# Autodesk Inventor assembly: Assembly1
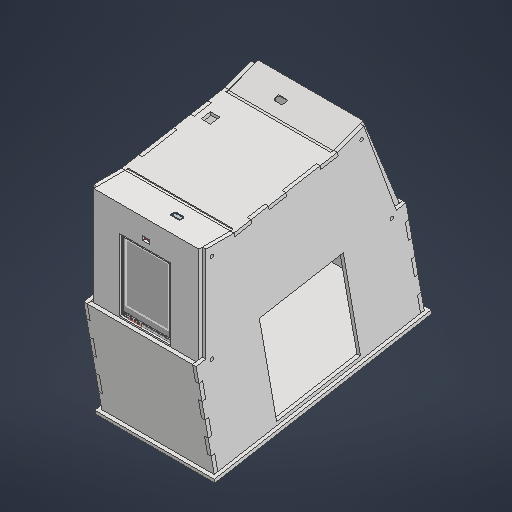
[picture p0: Inventor's stored thumbnail of the model, 512x512]
Saved by Autodesk Inventor 2027.1 (Build 311270010, 270A)
## iProperties
Created: 2026-10-11
Part Number: Assembly1
Document SubType Name: Assembly
Designer: MineS
Author: MineS
## Documents named in this file (10)
- C:\Users\MineS\Desktop\Carcasa videojuego\Assembly1.iam
- C:\Users\MineS\Desktop\Carcasa videojuego\NUCLEO-60-F401\NUCLEO-60-F401.ipt
- C:\Users\MineS\Desktop\Carcasa videojuego\2.4TFT_Module\2.4TFT_Module.ipt
- C:\Users\MineS\Desktop\Carcasa videojuego\base_stm.ipt
- C:\Users\MineS\Desktop\Carcasa videojuego\tapadera_pantalla.ipt
- C:\Users\MineS\Desktop\Carcasa videojuego\tapaderalateral.ipt
- C:\Users\MineS\Desktop\Carcasa videojuego\tapafrontalmdf.ipt
- C:\Users\MineS\Desktop\Carcasa videojuego\tapaderalateralbocina.ipt
- C:\Users\MineS\Desktop\Carcasa videojuego\baseabajo.ipt
- C:\Users\MineS\Desktop\Carcasa videojuego\tapasuperior.ipt
## Components (13 placed, 9 different names)
1. NUCLEO-60-F401:1 — Mate:1, Mate:2, Mate:3, Insert:1
2. 2.4TFT_Module:1 — Mate:1, Mate:2, Mate:3
3. base_stm:2 — Insert:1, Flush:1, Flush:2, Flush:3
4. tapadera_pantalla:1 — Flush:1, Flush:2, Flush:3, Flush:4, Insert:2
5. tapaderalateral:1 — Flush:4, Flush:5, Insert:4, Flush:6, Flush:8
6. tapafrontalmdf:1 — Flush:5
7. tapaderalateralbocina:1 — Insert:2, Mate:4, Mate:5, Flush:7
8. NUCLEO-60-F401:2
9. base_stm:3 — Insert:3, Insert:5
10. tapadera_pantalla:2 — Insert:3, Insert:4, Insert:5
11. tapafrontalmdf:2 — Mate:4, Mate:5, Flush:6
12. baseabajo:1 — Flush:7
13. tapasuperior:1 — Flush:8
## Relationships (18: Flush 8, Mate 5, Insert 5)
- Mate:1: NUCLEO-60-F401:1 ↔ 2.4TFT_Module:1
- Mate:2: NUCLEO-60-F401:1 ↔ 2.4TFT_Module:1
- Mate:3: NUCLEO-60-F401:1 ↔ 2.4TFT_Module:1
- Insert:1: NUCLEO-60-F401:1 ↔ base_stm:2
- Flush:1: base_stm:2 ↔ tapadera_pantalla:1
- Flush:2: base_stm:2 ↔ tapadera_pantalla:1
- Flush:3: base_stm:2 ↔ tapadera_pantalla:1
- Flush:4: tapadera_pantalla:1 ↔ tapaderalateral:1
- Flush:5: tapaderalateral:1 ↔ tapafrontalmdf:1
- Insert:2: tapadera_pantalla:1 ↔ tapaderalateralbocina:1
- Insert:3: base_stm:3 ↔ tapadera_pantalla:2
- Insert:4: tapaderalateral:1 ↔ tapadera_pantalla:2
- Insert:5: base_stm:3 ↔ tapadera_pantalla:2
- Mate:4: tapaderalateralbocina:1 ↔ tapafrontalmdf:2
- Mate:5: tapaderalateralbocina:1 ↔ tapafrontalmdf:2
- Flush:6: tapaderalateral:1 ↔ tapafrontalmdf:2
- Flush:7: tapaderalateralbocina:1 ↔ baseabajo:1
- Flush:8: tapaderalateral:1 ↔ tapasuperior:1
